# Autodesk Inventor assembly: MM0948AN002_G40_001
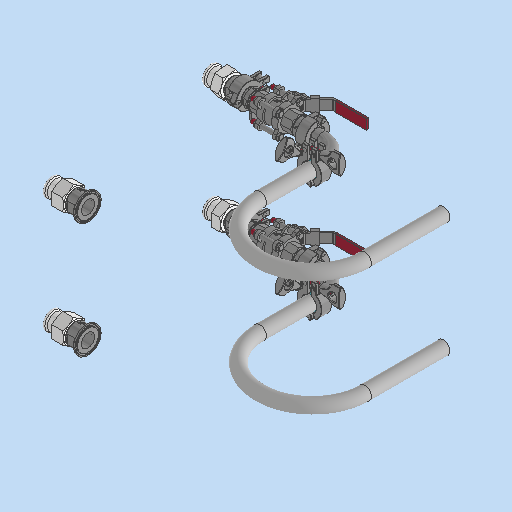
[picture p0: Inventor's stored thumbnail of the model, 512x512]
Saved by Autodesk Inventor 2023.3 (Build 273359000, 359)
## iProperties
RuleStatus: InUse
Created: 2023-03-23
Part Number: MM0948AN002_G40_001
Description: =<RBPARTNOTITLE2>
Document SubType Name: Assembly
Designer: FH/Wi
Mass: 8101.15 g
Surface Area: 4012.01 cm^2
Volume: 1159.33 cm^3
Density: 6.98781 g/cm^3
AnP_Kategorie: 99
AnP_Material: =<Material>
AnP_TemplVers: 20200821
RBDOCUMENTTYPE: DRF
RBDOCUMENTVERSION: 00
RBDRAWINGMAINSCALE: 1:1
RBDRAWINGMISSINGSPEC: --
RBDRAWINGVOLUME: --
RBDSV1: 0850
RBGBEDGESIN1: +0,5
RBGBEDGESIN2: +0,2
RBGBEDGESOUT1: -0,3
RBGBEDGESOUT2: -0,1
RBMATERIAL: =<Material>
RBMATMEETS: --
RBMATNO: =<Part Number>
RBPARTMADEOF: --
RBPARTNO: SIEHE MNR
RBPARTNOTITLE1: ball valve unit
RBPARTNOTITLE2: Absperreinheit
RBPARTSAFETYINDICATOR: --
RBSURFACE: --
RBSURFACE2: --
RBZEDGESNORM: ISO13715:2002-06
RBZGENDIMCLASS: m
RBZGENDIMNORM: ISO 2768-1:1989-11
RBZGENGEOCLASS: H
RBZGENGEONORM: ISO 2768-2:1989-11
RBZSURFACENORM: ISO13D2:2002-02
RBZTOLERANCENORM: ISO 14405-1:2010-12
Author: FH/Wi
Keywords: =<RBPARTMADEOF>
Comments: =<RBSURFACE2>
Revision Number: 01
## Documents named in this file (12)
- C:\Users\rea9an\Documents\Inventor\TCAI2412_te1910_EM\AS00000930.iam
- C:\Users\rea9an\Documents\Inventor\TCAI2412_te1910_EM\PT00004287.ipt
- C:\Users\rea9an\Documents\Inventor\TCAI2412_te1910_EM\PT00004360.ipt
- C:\Users\rea9an\Documents\Inventor\TCAI2412_te1910_EM\PT00004362.ipt
- C:\Users\rea9an\Documents\Inventor\TCAI2412_te1910_EM\PT00004361.ipt
- C:\Users\rea9an\Documents\Inventor\TCAI2412_te1910_EM\PT00004357.ipt
- C:\Users\rea9an\Documents\Inventor\TCAI2412_te1910_EM\PT00004584.ipt
- C:\Users\rea9an\Documents\Inventor\TCAI2412_te1910_EM\AS00000928.iam
- C:\Users\rea9an\Documents\Inventor\TCAI2412_te1910_EM\PT00004286.ipt
- C:\Users\rea9an\Documents\Inventor\TCAI2412_te1910_EM\PT00004363.ipt
- C:\Users\rea9an\Documents\Inventor\TCAI2412_te1910_EM\PT00004285.ipt
- C:\Users\rea9an\Documents\Inventor\TCAI2412_te1910_EM\PT00004356.ipt
## Components (34 placed, 11 different names)
1. AS00000928:1 [sub-assembly] — Passend:21, Passend:22, Winkel:2, Passend:25, Passend:26
2. AS00000928:2 [sub-assembly] — Passend:23, Passend:24, Winkel:3
3. PT00004362:5 — Passend:33, Passend:34, Passend:35, Passend:36
4. PT00004362:6 — Passend:31, Passend:32, Passend:39, Passend:40
5. PT00004287:4 — Passend:27, Passend:28, Passend:33
6. PT00004287:5 — Passend:29, Passend:30, Passend:31
7. PT00004361:4 — Passend:44, Passend:46, Winkel:5
8. PT00004361:5 — Passend:43, Passend:45, Winkel:4
9. PT00004362:7 — Passend:41, Passend:42, Passend:43, Passend:45, Einfügen:12
10. PT00004362:8 — Passend:37, Passend:38, Passend:44, Passend:46, Passend:48, Passend:51, Passend:52
11. PT00004360:4 — Passend:35, Passend:36, Passend:37, Passend:38
12. PT00004360:5 — Passend:39, Passend:40, Passend:41, Passend:42
13. PT00004286:1 — Einfügen:13
14. PT00004286:2 — Passend:48, Passend:53
15. PT00004287:6 — Passend:51, Passend:52, Passend:53
16. PT00004287:7 — Einfügen:12, Einfügen:13
17. PT00004287:2 — Einfügen:8, Einfügen:9
18. PT00004357:1 — Einfügen:8, Passend:1, Passend:6, Fluchtend:8, Passend:8, Passend:27, Passend:28, Passend:34
19. PT00004362:3 — Einfügen:9, Einfügen:10, Einfügen:11, Passend:21
20. PT00004361:2 — Einfügen:10
21. PT00004360:2 — Einfügen:11, Passend:22
22. PT00004584:1 — Passend:11, Passend:25, Passend:26
23. PT00004287:3
24. PT00004357:2 — Passend:29, Passend:30, Passend:32
25. PT00004362:4 — Passend:23
26. PT00004361:3
27. PT00004360:3 — Passend:24
28. PT00004584:2
29. PT00004285:1 — Passend:54, Passend:55, Passend:57, Fluchtend:9, Einfügen:14
30. PT00004356:1 — Passend:54, Passend:55
31. PT00004363:1 — Passend:56, Einfügen:14
32. PT00004285:2
33. PT00004356:2
34. PT00004363:2
## Component patterns: (2 elements, first: PT00004287:2 + PT00004357:1 + PT00004362:3 + PT00004361:2 + PT00004360:2 + PT00004584:1), (2 elements, first: PT00004285:1 + PT00004356:1 + PT00004363:1)
## Relationships (51: Mate 38, Insert 7, Angle 4, Flush 2)
- Einfügen:8 [Insert]: PT00004287:2 ↔ PT00004357:1
- Einfügen:9 [Insert]: PT00004287:2 ↔ PT00004362:3
- Einfügen:10 [Insert]: PT00004362:3 ↔ PT00004361:2
- Passend:1 [Mate] (110 mm): PT00004357:1
- Einfügen:11 [Insert]: PT00004362:3 ↔ PT00004360:2
- Passend:6 [Mate] (-2290 mm): PT00004357:1
- Fluchtend:8 [Flush] (1037 mm): PT00004357:1
- Passend:8 [Mate] (110 mm): PT00004357:1
- Passend:11 [Mate] (110 mm): PT00004584:1
- Passend:21 [Mate]: AS00000928:1 ↔ PT00004362:3
- Passend:22 [Mate]: AS00000928:1 ↔ PT00004360:2
- Winkel:2 [Angle] (180 deg): AS00000928:1
- Passend:23 [Mate]: AS00000928:2 ↔ PT00004362:4
- Passend:24 [Mate]: AS00000928:2 ↔ PT00004360:3
- Winkel:3 [Angle] (180 deg): AS00000928:2
- Passend:25 [Mate]: AS00000928:1 ↔ PT00004584:1
- Passend:26 [Mate]: AS00000928:1 ↔ PT00004584:1
- Passend:27 [Mate]: PT00004287:4 ↔ PT00004357:1
- Passend:28 [Mate]: PT00004287:4 ↔ PT00004357:1
- Passend:29 [Mate]: PT00004287:5 ↔ PT00004357:2
- Passend:30 [Mate]: PT00004287:5 ↔ PT00004357:2
- Passend:31 [Mate]: PT00004362:6 ↔ PT00004287:5
- Passend:32 [Mate]: PT00004362:6 ↔ PT00004357:2
- Passend:33 [Mate]: PT00004362:5 ↔ PT00004287:4
- Passend:34 [Mate]: PT00004362:5 ↔ PT00004357:1
- Passend:35 [Mate]: PT00004362:5 ↔ PT00004360:4
- Passend:36 [Mate]: PT00004362:5 ↔ PT00004360:4
- Passend:37 [Mate]: PT00004362:8 ↔ PT00004360:4
- Passend:38 [Mate]: PT00004362:8 ↔ PT00004360:4
- Passend:39 [Mate]: PT00004362:6 ↔ PT00004360:5
- Passend:40 [Mate]: PT00004362:6 ↔ PT00004360:5
- Passend:41 [Mate]: PT00004362:7 ↔ PT00004360:5
- Passend:42 [Mate]: PT00004362:7 ↔ PT00004360:5
- Passend:43 [Mate]: PT00004361:5 ↔ PT00004362:7
- Passend:44 [Mate]: PT00004361:4 ↔ PT00004362:8
- Passend:45 [Mate]: PT00004361:5 ↔ PT00004362:7
- Passend:46 [Mate]: PT00004361:4 ↔ PT00004362:8
- Winkel:4 [Angle] (0 deg): PT00004361:5
- Winkel:5 [Angle] (0 deg): PT00004361:4
- Passend:48 [Mate]: PT00004362:8 ↔ PT00004286:2
- Passend:51 [Mate]: PT00004362:8 ↔ PT00004287:6
- Passend:52 [Mate]: PT00004362:8 ↔ PT00004287:6
- Passend:53 [Mate]: PT00004286:2 ↔ PT00004287:6
- Einfügen:12 [Insert]: PT00004362:7 ↔ PT00004287:7
- Einfügen:13 [Insert]: PT00004286:1 ↔ PT00004287:7
- Passend:54 [Mate]: PT00004285:1 ↔ PT00004356:1
- Passend:55 [Mate] (-3 mm): PT00004285:1 ↔ PT00004356:1
- Passend:56 [Mate] (110 mm): PT00004363:1
- Passend:57 [Mate] (700 mm): PT00004285:1
- Fluchtend:9 [Flush] (-2500 mm): PT00004285:1
- Einfügen:14 [Insert] (3 mm): PT00004285:1 ↔ PT00004363:1
